# Autodesk Inventor assembly: AssemblyDriveShaft
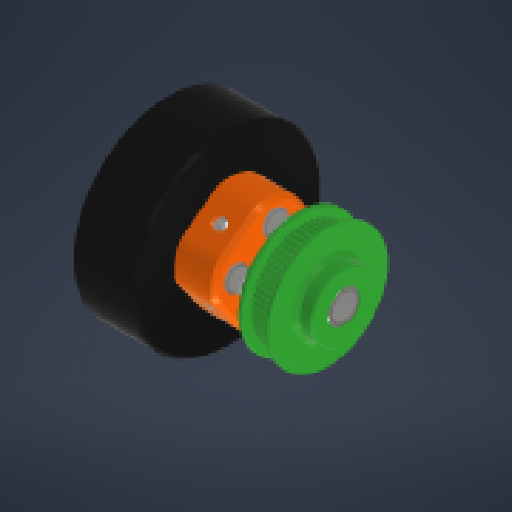
[picture p0: Inventor's stored thumbnail of the model, 512x512]
Saved by Autodesk Inventor 2027.1 (Build 311270010, 270A)
## iProperties
Created: 2026-10-15
Part Number: AssemblyDriveShaft
Document SubType Name: Assembly
Designer: lucao
Mass: 223.262 g
Surface Area: 470.522 cm^2
Volume: 92.0488 cm^3
Density: 2.42548 g/cm^3
Author: lucao
## Documents named in this file (9)
- C:\Users\lucao\Desktop\RL-Rotary-Inverted-Double-Pendulum\CAD\AssemblyDriveShaft.iam
- C:\Users\lucao\Desktop\RL-Rotary-Inverted-Double-Pendulum\CAD\motor_driveshaft.ipt
- C:\Users\lucao\Desktop\RL-Rotary-Inverted-Double-Pendulum\CAD\pulleyGT3_12mm.ipt
- C:\Users\lucao\Desktop\RL-Rotary-Inverted-Double-Pendulum\CAD\motor_flange.ipt
- C:\Users\lucao\Documents\Inventor\Content Center Files\R2027\en-US\DIN EN ISO 7091\DIN EN ISO 7091 - 4.ipt
- C:\Users\lucao\Documents\Inventor\Content Center Files\R2027\en-US\ISO 4762(1)\DIN EN ISO 4762 - M4 x 20.ipt
- C:\Users\lucao\Documents\Inventor\Content Center Files\R2027\en-US\ISO 4032(1)\ISO 4032 - M4DIN EN.ipt
- C:\Users\lucao\Documents\Inventor\Content Center Files\R2027\en-US\DIN 914\DIN 914 - M4 x 12.ipt
- C:\Users\lucao\Desktop\RL-Rotary-Inverted-Double-Pendulum\CAD\motor_movingPart.ipt
## Components (20 placed, 8 different names)
1. motor_driveshaft:1 — Mate:11, Mate:14, Mate:16
2. pulleyGT3_12mm:1 — Mate:8, Mate:15
3. motor_flange:1 — Mate:8, Mate:13
4. DIN EN ISO 7091 4:1
5. DIN EN ISO 7091 4:2
6. DIN EN ISO 7091 4:3
7. DIN EN ISO 7091 4:4
8. DIN EN ISO 4762 M4 x 20:1
9. DIN EN ISO 4762 M4 x 20:2
10. DIN EN ISO 4762 M4 x 20:3 — Mate:12
11. DIN EN ISO 4762 M4 x 20:4
12. motor_movingPart:1 — Mate:11, Mate:12, Mate:13, Mate:14
13. DIN EN 24032 M4:1
14. DIN EN 24032 M4:2
15. DIN EN 24032 M4:3
16. DIN EN 24032 M4:4
17. DIN 914 M4 x 12:1
18. DIN 914 M4 x 12:2
19. DIN 914 M4 x 12:3
20. DIN 914 M4 x 12:4
## Component patterns: (4 elements, first: DIN EN 24032 M4:1), (4 elements, first: DIN 914 M4 x 12:1)
## Relationships (20: Mate 10, Insert 9, Flush 1)
- [Mate]: motor_driveshaft:1 ↔ pulleyGT3_12mm:1
- [Mate]: motor_driveshaft:1 ↔ motor_flange:1
- [Insert]: motor_flange:1 ↔ DIN EN ISO 7091 4:1
- [Insert]: motor_flange:1 ↔ DIN EN ISO 7091 4:2
- [Insert]: motor_flange:1 ↔ DIN EN ISO 7091 4:3
- [Insert]: motor_flange:1 ↔ DIN EN ISO 7091 4:4
- [Insert]: DIN EN ISO 7091 4:1 ↔ DIN EN ISO 4762 M4 x 20:1
- [Insert]: DIN EN ISO 7091 4:4 ↔ DIN EN ISO 4762 M4 x 20:2
- [Insert]: DIN EN ISO 7091 4:3 ↔ DIN EN ISO 4762 M4 x 20:3
- [Insert]: DIN EN ISO 7091 4:2 ↔ DIN EN ISO 4762 M4 x 20:4
- [Insert]: motor_flange:1 ↔ DIN EN 24032 M4:1
- [Mate]: DIN EN 24032 M4:1 ↔ DIN 914 M4 x 12:1
- [Flush]: motor_flange:1 ↔ DIN 914 M4 x 12:1
- Mate:8 (10.5 mm): pulleyGT3_12mm:1 ↔ motor_flange:1
- Mate:11: motor_driveshaft:1 ↔ motor_movingPart:1
- Mate:12: DIN EN ISO 4762 M4 x 20:3 ↔ motor_movingPart:1
- Mate:13: motor_flange:1 ↔ motor_movingPart:1
- Mate:14: motor_driveshaft:1 ↔ motor_movingPart:1
- Mate:15 (4 mm): pulleyGT3_12mm:1
- Mate:16: motor_driveshaft:1
